# Autodesk Inventor assembly: Assembly_SIMMO_2
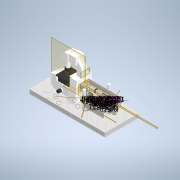
[picture p0: Inventor's stored thumbnail of the model, 180x180]
Saved by Autodesk Inventor 2022 (Build 260153000, 153)
## iProperties
Created: 2022-04-09
Part Number: Assembly_SIMMO_2
Document SubType Name: Assembly
Designer: Prakash Lab
Author: Prakash Lab
## Documents named in this file (27)
- C:\Users\diederichbenedict\Dropbox\Dokumente\Promotion\PROJECTS\SIMMO\INVENTOR\Assembly_SIMMO_2.iam
- C:\Users\diederichbenedict\Dropbox\Dokumente\Promotion\PROJECTS\SIMMO\INVENTOR\00_AC254-200-A-ML-Step.ipt
- C:\Users\diederichbenedict\Dropbox\Dokumente\Promotion\PROJECTS\SIMMO\INVENTOR\Adapter_DMD_KM100.ipt
- C:\Users\diederichbenedict\Dropbox\Dokumente\Promotion\PROJECTS\SIMMO\INVENTOR\Cover_new.ipt
- C:\Users\diederichbenedict\Dropbox\Dokumente\Promotion\PROJECTS\SIMMO\INVENTOR\KM100-Solidworks.ipt
- C:\Users\diederichbenedict\Dropbox\Dokumente\Promotion\PROJECTS\SIMMO\INVENTOR\Mount_new.ipt
- C:\Users\diederichbenedict\Dropbox\Dokumente\Promotion\PROJECTS\SIMMO\INVENTOR\Nikon_Ti2E.ipt
- C:\Users\diederichbenedict\Dropbox\Dokumente\Promotion\PROJECTS\SIMMO\INVENTOR\00_AC254-030-A-ML-Step.ipt
- C:\Users\diederichbenedict\Dropbox\Dokumente\Promotion\PROJECTS\SIMMO\INVENTOR\00_AC254-075-A-ML-Step.ipt
- C:\Users\diederichbenedict\Dropbox\Dokumente\Promotion\PROJECTS\SIMMO\INVENTOR\00_Beampath_v0.ipt
- C:\Users\diederichbenedict\Dropbox\Dokumente\Promotion\PROJECTS\SIMMO\INVENTOR\00_Assembly_Axiovert.ipt
- C:\Users\diederichbenedict\Dropbox\Dokumente\Promotion\PROJECTS\SIMMO\INVENTOR\00_CP33T_M-Step.ipt
- C:\Users\diederichbenedict\Dropbox\Dokumente\Promotion\PROJECTS\SIMMO\INVENTOR\00_KM100-Step.ipt
- C:\Users\diederichbenedict\Dropbox\Dokumente\Promotion\PROJECTS\SIMMO\INVENTOR\00_P1-305A-FC-1-Step.ipt
- C:\Users\diederichbenedict\Dropbox\Dokumente\Promotion\PROJECTS\SIMMO\INVENTOR\00_PF10-03-P01-Solidworks.ipt
- C:\Users\diederichbenedict\Dropbox\Dokumente\Promotion\PROJECTS\SIMMO\INVENTOR\00_Thorlabs_6mm_rods_300mm.ipt
- C:\Users\diederichbenedict\Dropbox\Dokumente\Promotion\PROJECTS\SIMMO\INVENTOR\00_Baseplate_Simmo_base.ipt
- C:\Users\diederichbenedict\Dropbox\Dokumente\Promotion\PROJECTS\SIMMO\INVENTOR\00_B3060L-Step.ipt
- C:\Users\diederichbenedict\Dropbox\Dokumente\Promotion\PROJECTS\SIMMO\INVENTOR\Assembly_Post_v0.iam
- C:\Users\diederichbenedict\Dropbox\Dokumente\Promotion\PROJECTS\SIMMO\INVENTOR\00_PCO_edge-det.ipt
- C:\Users\diederichbenedict\Dropbox\Dokumente\Promotion\PROJECTS\SIMMO\INVENTOR\00_Baseplate_Simmo_side1.ipt
- C:\Users\diederichbenedict\Dropbox\Dokumente\Promotion\PROJECTS\SIMMO\INVENTOR\00_Baseplate_Simmo_side3.ipt
- C:\Users\diederichbenedict\Dropbox\Dokumente\Promotion\PROJECTS\SIMMO\INVENTOR\00_Baseplate_Simmo_side2.ipt
- C:\Users\diederichbenedict\Dropbox\Dokumente\Promotion\PROJECTS\SIMMO\INVENTOR\00_Baseplate_Simmo_side4.ipt
- C:\Users\diederichbenedict\Dropbox\Dokumente\Promotion\PROJECTS\SIMMO\INVENTOR\00_Aluminium_Extrusion_20x20.ipt
- C:\Users\diederichbenedict\Dropbox\Dokumente\Promotion\PROJECTS\SIMMO\INVENTOR\00_TR20_M-Step.ipt
- C:\Users\diederichbenedict\Dropbox\Dokumente\Promotion\PROJECTS\SIMMO\INVENTOR\10_Mountinplate_Mirrors_v0.ipt
## Components (45 placed, 26 different names)
1. Adapter_DMD_KM100:1 — Insert:5, Mate:5, Insert:6, Mate:6
2. KM100-Solidworks:1 — Insert:6, Angle:3, Einfügen:32
3. Mount_new:1 — Mate:6
4. Nikon_Ti2E:1 — Mate:1, Mate:2, Mate:3, Flush:1, Flush:2, Flush:4, Mate:10, Mate:11, Angle:6, Fluchtend:5, Fluchtend:6, Einfügen:17, Einfügen:18, Einfügen:19, Fluchtend:7, Fluchtend:8, Passend:25, Passend:26
5. 00_Beampath_v0:1 — Flush:1, Flush:2, Insert:1, Insert:2, Insert:3, Angle:1, Mate:12, Insert:13, Mate:18, Mate:19, Flush:11, Insert:23, Insert:25, Insert:27, Insert:29
6. 00_AC254-200-A-ML-Step:1 — Insert:1
7. 00_AC254-075-A-ML-Step:1 — Insert:2, Insert:8
8. 00_AC254-075-A-ML-Step:2 — Insert:3, Insert:9
9. Cover_new:1 — Angle:1, Angle:2, Insert:5, Mate:5
10. 00_Assembly_Axiovert:1 — Flush:4, Mate:10, Mate:11, Mate:12, Passend:13, Einfügen:20
11. 00_CP33T_M-Step:1 — Insert:8
12. 00_CP33T_M-Step:2 — Insert:9
13. 00_KM100-Step:2 — Insert:16, Angle:8, Einfügen:33, Winkel:10
14. 00_P1-305A-FC-1-Step:1 — Insert:28
15. 00_KM100-Step:3 — Insert:14, Angle:6, Einfügen:31
16. 00_PF10-03-P01-Solidworks:1 — Insert:13, Insert:14
17. 00_PF10-03-P01-Solidworks:2 — Insert:16, Insert:23
18. 00_Thorlabs_6mm_rods_300mm:1 — Fluchtend:5, Fluchtend:6
19. 00_Thorlabs_6mm_rods_300mm:2 — Einfügen:17
20. 00_Thorlabs_6mm_rods_300mm:3 — Einfügen:19
21. 00_Thorlabs_6mm_rods_300mm:4 — Einfügen:18
22. 00_KM100-Step:4
23. Assembly_Post_v0:1 [sub-assembly]
24. Assembly_Post_v0:2 [sub-assembly] — Passend:17
25. 00_PCO_edge-det:1 — Einfügen:20
26. 00_Baseplate_Simmo_side1:1 — Fluchtend:9, Fluchtend:10
27. 00_KM100-Step:5 — Insert:21, Angle:9, Fluchtend:17, Fluchtend:18
28. 00_PF10-03-P01-Solidworks:3 — Insert:21, Insert:25
29. 00_P1-305A-FC-1-Step:2 — Insert:26
30. 00_AC254-030-A-ML-Step:2 — Insert:26, Insert:27
31. 00_Baseplate_Simmo_side3:1 — Passend:20, Fluchtend:14, Passend:21
32. 00_Baseplate_Simmo_side2 — Flush:15
33. 00_Baseplate_Simmo_side4:1 — Passend:22, Fluchtend:16, Passend:23
34. 00_Aluminium_Extrusion_20x20:1 — Passend:24, Passend:25, Passend:26
35. 00_AC254-030-A-ML-Step:3 — Insert:28, Insert:29
36. 00_TR20_M-Step:2 — Einfügen:31
37. 00_TR20_M-Step:3 — Einfügen:32
38. 10_Mountinplate_Mirrors_v0:1 — Fluchtend:17, Fluchtend:18
39. 10_Mountinplate_Mirrors_v0:2 — Einfügen:33, Winkel:10
40. 00_B3060L-Step:1 — Passend:13, Passend:17
41. 00_B3060L-Step:2
42. 00_B3060L-Step:3
43. 00_B3060L-Step:4
44. 00_Baseplate_Simmo_base:1 — Fluchtend:7, Fluchtend:8, Fluchtend:9, Fluchtend:10, Flush:11, Angle:8, Angle:9, Passend:20, Fluchtend:14, Passend:21, Flush:15, Passend:22, Fluchtend:16, Passend:23, Passend:24
45. 00_Baseplate_Simmo_base:2
## Component patterns: (4 elements, first: 00_B3060L-Step:1), (2 elements, first: 00_Baseplate_Simmo_base:1)
## Relationships (68: Insert 24, Mate 21, Flush 15, Angle 8)
- Mate:1: Nikon_Ti2E:1
- Mate:2: Nikon_Ti2E:1
- Mate:3: Nikon_Ti2E:1
- Flush:1: Nikon_Ti2E:1 ↔ 00_Beampath_v0:1
- Flush:2: Nikon_Ti2E:1 ↔ 00_Beampath_v0:1
- Insert:1: 00_Beampath_v0:1 ↔ 00_AC254-200-A-ML-Step:1
- Insert:2: 00_Beampath_v0:1 ↔ 00_AC254-075-A-ML-Step:1
- Insert:3: 00_Beampath_v0:1 ↔ 00_AC254-075-A-ML-Step:2
- Angle:1 (190 deg): 00_Beampath_v0:1 ↔ Cover_new:1
- Angle:2 (0 deg): Cover_new:1
- Insert:5 (5 mm): Adapter_DMD_KM100:1 ↔ Cover_new:1
- Mate:5: Adapter_DMD_KM100:1 ↔ Cover_new:1
- Insert:6 (8 mm): Adapter_DMD_KM100:1 ↔ KM100-Solidworks:1
- Mate:6 (20 mm): Adapter_DMD_KM100:1 ↔ Mount_new:1
- Angle:3 (0 deg): KM100-Solidworks:1
- Flush:4: Nikon_Ti2E:1 ↔ 00_Assembly_Axiovert:1
- Mate:10: Nikon_Ti2E:1 ↔ 00_Assembly_Axiovert:1
- Mate:11: Nikon_Ti2E:1 ↔ 00_Assembly_Axiovert:1
- Mate:12 (-194 mm): 00_Beampath_v0:1 ↔ 00_Assembly_Axiovert:1
- Insert:8: 00_AC254-075-A-ML-Step:1 ↔ 00_CP33T_M-Step:1
- Insert:9: 00_AC254-075-A-ML-Step:2 ↔ 00_CP33T_M-Step:2
- Insert:13: 00_Beampath_v0:1 ↔ 00_PF10-03-P01-Solidworks:1
- Insert:14: 00_KM100-Step:3 ↔ 00_PF10-03-P01-Solidworks:1
- Angle:6 (0 deg): Nikon_Ti2E:1 ↔ 00_KM100-Step:3
- Insert:16: 00_KM100-Step:2 ↔ 00_PF10-03-P01-Solidworks:2
- Fluchtend:5 [Flush]: Nikon_Ti2E:1 ↔ 00_Thorlabs_6mm_rods_300mm:1
- Fluchtend:6 [Flush]: Nikon_Ti2E:1 ↔ 00_Thorlabs_6mm_rods_300mm:1
- Einfügen:17 [Insert]: Nikon_Ti2E:1 ↔ 00_Thorlabs_6mm_rods_300mm:2
- Einfügen:18 [Insert]: Nikon_Ti2E:1 ↔ 00_Thorlabs_6mm_rods_300mm:4
- Einfügen:19 [Insert]: Nikon_Ti2E:1 ↔ 00_Thorlabs_6mm_rods_300mm:3
- Fluchtend:7 [Flush]: Nikon_Ti2E:1 ↔ 00_Baseplate_Simmo_base:1
- Fluchtend:8 [Flush]: Nikon_Ti2E:1 ↔ 00_Baseplate_Simmo_base:1
- Passend:13 [Mate]: 00_Assembly_Axiovert:1 ↔ 00_B3060L-Step:1
- [Mate]: Assembly_Post_v0:1 ↔ 00_B3060L-Step:1
- [Mate]: Assembly_Post_v0:1 ↔ 00_Baseplate_Simmo_base:1
- [Angle] (0 deg): Assembly_Post_v0:1 ↔ 00_B3060L-Step:1
- Passend:17 [Mate]: Assembly_Post_v0:2 ↔ 00_B3060L-Step:1
- Einfügen:20 [Insert]: 00_Assembly_Axiovert:1 ↔ 00_PCO_edge-det:1
- Fluchtend:9 [Flush]: 00_Baseplate_Simmo_side1:1 ↔ 00_Baseplate_Simmo_base:1
- Fluchtend:10 [Flush]: 00_Baseplate_Simmo_side1:1 ↔ 00_Baseplate_Simmo_base:1
- Insert:21: 00_KM100-Step:5 ↔ 00_PF10-03-P01-Solidworks:3
- Mate:18: 00_Beampath_v0:1
- Mate:19: 00_Beampath_v0:1
- Flush:11: 00_Beampath_v0:1 ↔ 00_Baseplate_Simmo_base:1
- Insert:23: 00_Beampath_v0:1 ↔ 00_PF10-03-P01-Solidworks:2
- Insert:25: 00_Beampath_v0:1 ↔ 00_PF10-03-P01-Solidworks:3
- Insert:26 (50 mm): 00_P1-305A-FC-1-Step:2 ↔ 00_AC254-030-A-ML-Step:2
- Insert:27: 00_Beampath_v0:1 ↔ 00_AC254-030-A-ML-Step:2
- Angle:8 (180 deg): 00_KM100-Step:2 ↔ 00_Baseplate_Simmo_base:1
- Angle:9 (180 deg): 00_KM100-Step:5 ↔ 00_Baseplate_Simmo_base:1
- Passend:20 [Mate]: 00_Baseplate_Simmo_side3:1 ↔ 00_Baseplate_Simmo_base:1
- Fluchtend:14 [Flush]: 00_Baseplate_Simmo_side3:1 ↔ 00_Baseplate_Simmo_base:1
- Passend:21 [Mate] (0.1 mm): 00_Baseplate_Simmo_side3:1 ↔ 00_Baseplate_Simmo_base:1
- Flush:15: 00_Baseplate_Simmo_side2 ↔ 00_Baseplate_Simmo_base:1
- Passend:22 [Mate]: 00_Baseplate_Simmo_side4:1 ↔ 00_Baseplate_Simmo_base:1
- Fluchtend:16 [Flush]: 00_Baseplate_Simmo_side4:1 ↔ 00_Baseplate_Simmo_base:1
- Passend:23 [Mate]: 00_Baseplate_Simmo_side4:1 ↔ 00_Baseplate_Simmo_base:1
- Passend:24 [Mate]: 00_Aluminium_Extrusion_20x20:1 ↔ 00_Baseplate_Simmo_base:1
- Passend:25 [Mate]: Nikon_Ti2E:1 ↔ 00_Aluminium_Extrusion_20x20:1
- Passend:26 [Mate]: Nikon_Ti2E:1 ↔ 00_Aluminium_Extrusion_20x20:1
- Insert:28 (-50 mm): 00_P1-305A-FC-1-Step:1 ↔ 00_AC254-030-A-ML-Step:3
- Insert:29: 00_Beampath_v0:1 ↔ 00_AC254-030-A-ML-Step:3
- Einfügen:31 [Insert]: 00_KM100-Step:3 ↔ 00_TR20_M-Step:2
- Einfügen:32 [Insert]: KM100-Solidworks:1 ↔ 00_TR20_M-Step:3
- Fluchtend:17 [Flush]: 00_KM100-Step:5 ↔ 10_Mountinplate_Mirrors_v0:1
- Fluchtend:18 [Flush]: 00_KM100-Step:5 ↔ 10_Mountinplate_Mirrors_v0:1
- Einfügen:33 [Insert]: 00_KM100-Step:2 ↔ 10_Mountinplate_Mirrors_v0:2
- Winkel:10 [Angle] (0 deg): 00_KM100-Step:2 ↔ 10_Mountinplate_Mirrors_v0:2
